# Autodesk Inventor assembly: CF70-nipple-65mm
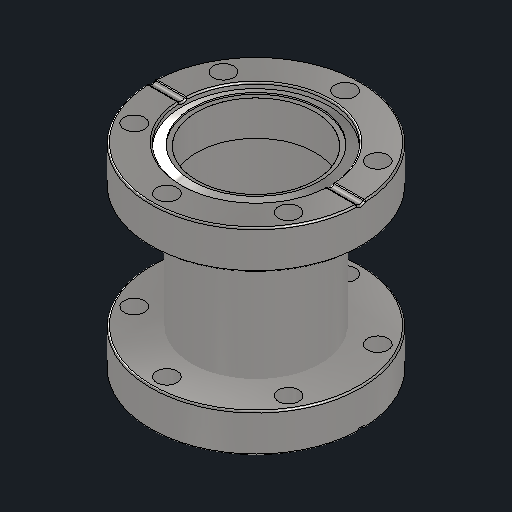
[picture p0: Inventor's stored thumbnail of the model, 512x512]
Saved by Autodesk Inventor 2027.1 (Build 311270010, 270A)
## iProperties
Created: 2022-11-16
Part Number: CF70-nipple-65mm
Document SubType Name: Assembly
Designer: kuzmin
Mass: 550.715 g
Surface Area: 368.58 cm^2
Volume: 71.06 cm^3
Density: 7.75 g/cm^3
Author: kuzmin
## Documents named in this file (3)
- C:\Users\queezz\Dropbox\Drawings\pihti-cad\ContentCenter\CF-parts\CF70-nipple\CF70-nipple-65mm.iam
- C:\Users\queezz\Dropbox\Drawings\pihti-cad\ContentCenter\CF-parts\CF70-nipple\cf70_hole_nipple.ipt
- C:\Users\queezz\Dropbox\Drawings\pihti-cad\ContentCenter\CF-parts\CF70-nipple\CF70-nipple-tube-65mm.ipt
## Components (3 placed, 2 different names)
1. cf70_hole_nipple:1 — Mate:1, Flush:1, Mate:3
2. cf70_hole_nipple:2 — Mate:2, Flush:2, Mate:3
3. CF70-nipple-tube-65mm:1 — Mate:1, Mate:2, Flush:1, Flush:2
## Relationships (5: Mate 3, Flush 2)
- Mate:1: cf70_hole_nipple:1 ↔ CF70-nipple-tube-65mm:1
- Mate:2: cf70_hole_nipple:2 ↔ CF70-nipple-tube-65mm:1
- Flush:1: cf70_hole_nipple:1 ↔ CF70-nipple-tube-65mm:1
- Flush:2: cf70_hole_nipple:2 ↔ CF70-nipple-tube-65mm:1
- Mate:3 (-65 mm): cf70_hole_nipple:1 ↔ cf70_hole_nipple:2
